# Autodesk Inventor assembly: mini pc
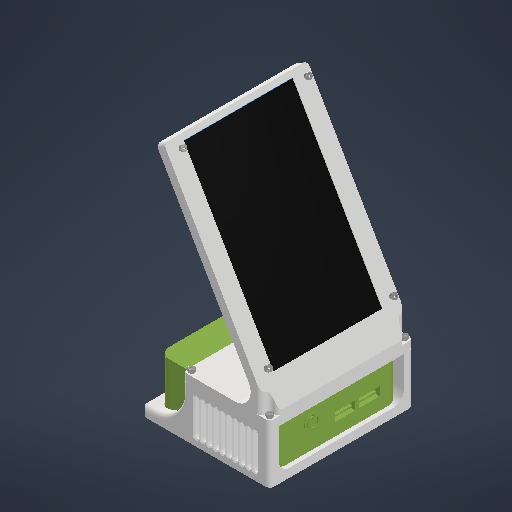
[picture p0: Inventor's stored thumbnail of the model, 512x512]
Saved by Autodesk Inventor 2027.1 (Build 311270010, 270A)
## iProperties
Created: 2026-10-10
Part Number: mini pc
Document SubType Name: Assembly
Designer: work
Author: work
## Documents named in this file (6)
- C:\Users\work\Desktop\Mini WebServer\모델링\MINI PC v1\mini pc.iam
- C:\Users\work\Desktop\Mini WebServer\모델링\MINI PC v1\FLOOR PARTS.ipt
- C:\Users\work\Desktop\Mini WebServer\모델링\MINI PC v1\PC.ipt
- C:\Users\work\Desktop\Mini WebServer\모델링\MINI PC v1\STAND PARTS.ipt
- C:\Users\work\Desktop\Mini WebServer\모델링\MINI PC v1\7inch diplay.ipt
- C:\Users\work\Desktop\Mini WebServer\모델링\MINI PC v1\JIS B 1176 - M3 x 12 - 0.5.ipt
## Components (12 placed, 5 different names)
1. FLOOR PARTS:1 — 메이트:1, 메이트:2, 각도:1, 메이트:3, 메이트:4, 메이트:5, 메이트:6
2. PC:1 — 메이트:1, 메이트:2, 각도:1
3. STAND PARTS:1 — 메이트:3, 메이트:4, 메이트:5, 메이트:6, 메이트:7, 메이트:8, 각도:2, 삽입:1, 삽입:2, 삽입:3, 삽입:4, 삽입:5, 삽입:6, 삽입:7, 삽입:8
4. 7inch diplay:1 — 메이트:7, 메이트:8, 각도:2
5. JIS B 1176 - M3 x 12 - 0.5:1 — 삽입:1
6. JIS B 1176 - M3 x 12 - 0.5:2 — 삽입:2
7. JIS B 1176 - M3 x 12 - 0.5:3 — 삽입:3
8. JIS B 1176 - M3 x 12 - 0.5:4 — 삽입:4
9. JIS B 1176 - M3 x 12 - 0.5:5 — 삽입:5
10. JIS B 1176 - M3 x 12 - 0.5:6 — 삽입:6
11. JIS B 1176 - M3 x 12 - 0.5:7 — 삽입:7
12. JIS B 1176 - M3 x 12 - 0.5:8 — 삽입:8
## Relationships (18: Mate 8, Insert 8, Angle 2)
- 메이트:1 [Mate]: FLOOR PARTS:1 ↔ PC:1
- 메이트:2 [Mate]: FLOOR PARTS:1 ↔ PC:1
- 각도:1 [Angle] (0 deg): FLOOR PARTS:1 ↔ PC:1
- 메이트:3 [Mate]: FLOOR PARTS:1 ↔ STAND PARTS:1
- 메이트:4 [Mate]: FLOOR PARTS:1 ↔ STAND PARTS:1
- 메이트:5 [Mate]: FLOOR PARTS:1 ↔ STAND PARTS:1
- 메이트:6 [Mate]: FLOOR PARTS:1 ↔ STAND PARTS:1
- 메이트:7 [Mate]: STAND PARTS:1 ↔ 7inch diplay:1
- 메이트:8 [Mate]: STAND PARTS:1 ↔ 7inch diplay:1
- 각도:2 [Angle] (0 deg): STAND PARTS:1 ↔ 7inch diplay:1
- 삽입:1 [Insert]: STAND PARTS:1 ↔ JIS B 1176 - M3 x 12 - 0.5:1
- 삽입:2 [Insert]: STAND PARTS:1 ↔ JIS B 1176 - M3 x 12 - 0.5:2
- 삽입:3 [Insert]: STAND PARTS:1 ↔ JIS B 1176 - M3 x 12 - 0.5:3
- 삽입:4 [Insert]: STAND PARTS:1 ↔ JIS B 1176 - M3 x 12 - 0.5:4
- 삽입:5 [Insert]: STAND PARTS:1 ↔ JIS B 1176 - M3 x 12 - 0.5:5
- 삽입:6 [Insert]: STAND PARTS:1 ↔ JIS B 1176 - M3 x 12 - 0.5:6
- 삽입:7 [Insert]: STAND PARTS:1 ↔ JIS B 1176 - M3 x 12 - 0.5:7
- 삽입:8 [Insert]: STAND PARTS:1 ↔ JIS B 1176 - M3 x 12 - 0.5:8
